# Autodesk Inventor assembly: Wheel_Assembly
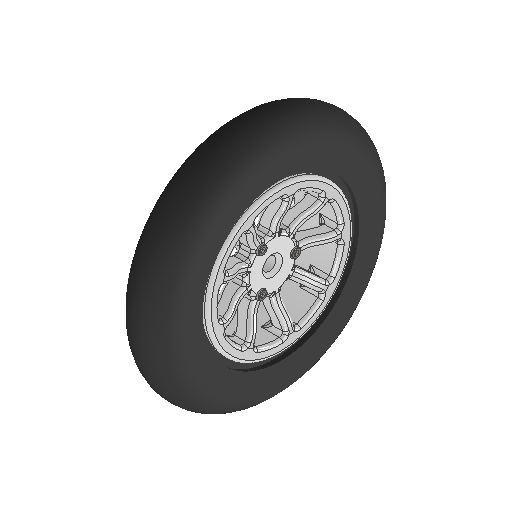
[picture p0: Inventor's stored thumbnail of the model, 512x512]
Saved by Autodesk Inventor 2025 (Build 290162000, 162)
## iProperties
Created: 2024-11-15
Part Number: Wheel_Assembly
Document SubType Name: Assembly
Designer: OSB
Mass: 237.118 g
Surface Area: 650.777 cm^2
Volume: 343.365 cm^3
Density: 0.69057 g/cm^3
Sending System: Autodesk Inventor 2021
Preprocessor: unknown
Minimum Resolution: 0.01
Sent Units: Millimeter
Translation Standard: IGES 5.3
Model Creation Time: 2020-07-07
Title: S500 Frame
Author: OSB
## Documents named in this file (5)
- C:\Users\OSB\Desktop\SB\1.Projects\캡스톤 디자인(2)_Paper\Modeling\Implementation_Design\Ver_004_mass_update\Wheel_Assembly.iam
- C:\Users\OSB\Desktop\SB\1.Projects\캡스톤 디자인(2)_Paper\Modeling\Implementation_Design\Ver_004_mass_update\Wheel.ipt
- C:\Users\OSB\Desktop\SB\1.Projects\캡스톤 디자인(2)_Paper\Modeling\Implementation_Design\Ver_004_mass_update\Tire.ipt
- C:\Users\OSB\Desktop\SB\1.Projects\캡스톤 디자인(2)_Paper\Modeling\Implementation_Design\Ver_004_mass_update\Wheel_Spacer.ipt
- C:\Users\OSB\Documents\Inventor\Content Center Files\R2025\ko-KR\KS B 1003\KS B 1003 - M 3 x 16.ipt
## Components (6 placed, 4 different names)
1. Wheel:1 — 회전:1, 메이트:1, 삽입:1, 삽입:2, 삽입:3, 메이트:2, 플러쉬:1
2. Tire:1 — 메이트:2, 플러쉬:1
3. Wheel_Spacer:1 — 회전:1, 메이트:1
4. KS B 1003 - 미터 M 3 x 16:1 — 삽입:1
5. KS B 1003 - 미터 M 3 x 16:2 — 삽입:2
6. KS B 1003 - 미터 M 3 x 16:3 — 삽입:3
## Relationships (7: Insert 3, Mate 2, RevoluteJoint 1, Flush 1)
- 회전:1 [RevoluteJoint]: Wheel:1 ↔ Wheel_Spacer:1
- 메이트:1 [Mate]: Wheel:1 ↔ Wheel_Spacer:1
- 삽입:1 [Insert]: Wheel:1 ↔ KS B 1003 - 미터 M 3 x 16:1
- 삽입:2 [Insert]: Wheel:1 ↔ KS B 1003 - 미터 M 3 x 16:2
- 삽입:3 [Insert]: Wheel:1 ↔ KS B 1003 - 미터 M 3 x 16:3
- 메이트:2 [Mate]: Wheel:1 ↔ Tire:1
- 플러쉬:1 [Flush]: Wheel:1 ↔ Tire:1
